# Autodesk Inventor assembly: Assembly_simu
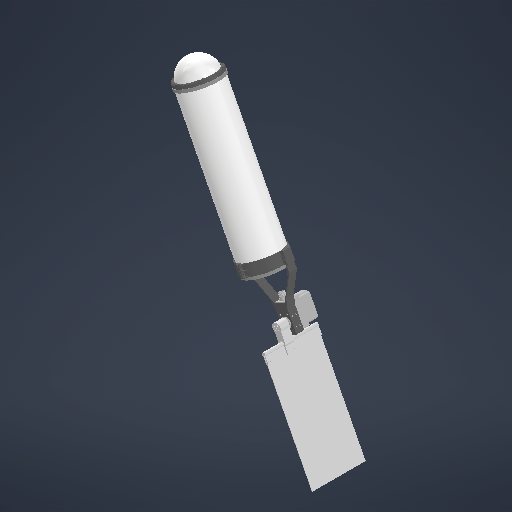
[picture p0: Inventor's stored thumbnail of the model, 512x512]
Saved by Autodesk Inventor 2026.1 (Build 301233000, 233)
## iProperties
Created: 2026-10-29
Part Number: Assembly_simu
Document SubType Name: Assembly
Designer: elodi
Author: elodi
## Documents named in this file (3)
- C:\Users\elodi\Documents\Ingenieurie Systeme\Assembly_simu.iam
- C:\Users\elodi\Documents\Ingenieurie Systeme\CAO_pale\Assemblypale_V2.iam
- C:\Users\elodi\Downloads\Assembly\Assembly\Assembly.iam
## Components (2 placed, 2 different names)
1. Assemblypale_V2:1 [sub-assembly] — Mate:1, Mate:2, Mate:3
2. Assembly:1 [sub-assembly] — Mate:1, Mate:2, Mate:3
## Relationships (3: Mate 3)
- Mate:1: Assemblypale_V2:1 ↔ Assembly:1
- Mate:2: Assemblypale_V2:1 ↔ Assembly:1
- Mate:3: Assemblypale_V2:1 ↔ Assembly:1
